# Autodesk Inventor assembly: BEVEL+SPIDER BOX
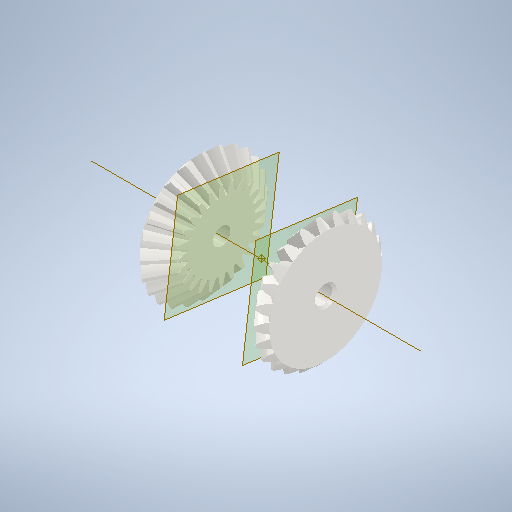
[picture p0: Inventor's stored thumbnail of the model, 512x512]
Saved by Autodesk Inventor 2026.3 (Build 303398000, 398)
## iProperties
Created: 2026-10-19
Part Number: BEVEL+SPIDER BOX
Document SubType Name: Assembly
Designer: Salim
Author: Salim
## Documents named in this file (8)
- C:\Users\Salim\OneDrive - Universitas Negeri Malang\!! MIZURO\!!!!!!!!KSTI 2026\mizuro-ksti2026-muv\mechanical\3d design\BEVEL+SPIDER BOX.iam
- C:\Users\Salim\OneDrive - Universitas Negeri Malang\!! MIZURO\!!!!!!!!KSTI 2026\mizuro-ksti2026-muv\mechanical\3d design\3DP DIFF\Design Accelerator\Bevel Gears2.iam
- C:\Users\Salim\OneDrive - Universitas Negeri Malang\!! MIZURO\!!!!!!!!KSTI 2026\mizuro-ksti2026-muv\mechanical\3d design\3DP DIFF\Design Accelerator\Bevel Gears2_MIR.iam
- C:\Users\Salim\OneDrive - Universitas Negeri Malang\!! MIZURO\!!!!!!!!KSTI 2026\mizuro-ksti2026-muv\mechanical\3d design\4MM ROD.ipt
- C:\Users\Salim\OneDrive - Universitas Negeri Malang\!! MIZURO\!!!!!!!!KSTI 2026\mizuro-ksti2026-muv\mechanical\3d design\SPIDER GEAR BOX.ipt
- C:\Users\Salim\OneDrive - Universitas Negeri Malang\!! MIZURO\!!!!!!!!KSTI 2026\mizuro-ksti2026-muv\mechanical\3d design\3DP DIFF\Design Accelerator\Bevel Gears2_MIR1.iam
- C:\Users\Salim\OneDrive - Universitas Negeri Malang\!! MIZURO\!!!!!!!!KSTI 2026\mizuro-ksti2026-muv\mechanical\3d design\3DP DIFF\Design Accelerator\Spur Gears2.iam
- C:\Users\Salim\OneDrive - Universitas Negeri Malang\!! MIZURO\!!!!!!!!KSTI 2026\mizuro-ksti2026-muv\mechanical\3d design\3DP DIFF\Design Accelerator\Spur Gears3.iam
## Components (8 placed, 6 different names)
1. Bevel Gears:1 [sub-assembly] — Mate:1, Angle:1, Rigid:1, Mate:2, Mate:3
2. Bevel Gears2_MIR:1 [sub-assembly] — Rigid:2
3. 4MM ROD:1 — Rigid:1
4. 4MM ROD:2 — Rigid:2
5. SPIDER GEAR BOX:1 — Mate:2, Mate:3, Rigid:3, Mate:10
6. Bevel Gears2_MIR1:1 [sub-assembly]
7. Spur Gears:1 [sub-assembly] — Rigid:3, Rigid:4, Mate:10, Mate:11
8. Spur Gears:2 [sub-assembly] — Rigid:4, Mate:11
## Relationships (10: Mate 5, WeldJoint 4, Angle 1)
- Mate:1: Bevel Gears:1
- Angle:1 (0 deg): Bevel Gears:1
- Rigid:1 [WeldJoint]: Bevel Gears:1 ↔ 4MM ROD:1
- Rigid:2 [WeldJoint]: Bevel Gears2_MIR:1 ↔ 4MM ROD:2
- Mate:2: Bevel Gears:1 ↔ SPIDER GEAR BOX:1
- Mate:3: Bevel Gears:1 ↔ SPIDER GEAR BOX:1
- Rigid:3 [WeldJoint]: SPIDER GEAR BOX:1 ↔ Spur Gears:1
- Rigid:4 [WeldJoint]: Spur Gears:1 ↔ Spur Gears:2
- Mate:10: SPIDER GEAR BOX:1 ↔ Spur Gears:1
- Mate:11: Spur Gears:1 ↔ Spur Gears:2
